# Autodesk Inventor assembly: PIHTI-for-Boron
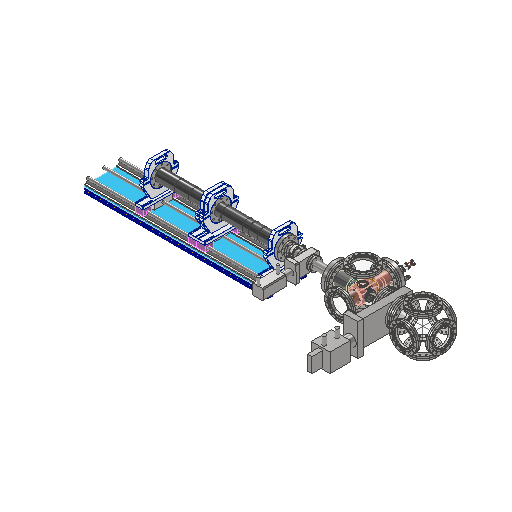
[picture p0: Inventor's stored thumbnail of the model, 512x512]
Saved by Autodesk Inventor 2027.1 (Build 311270010, 270A)
## iProperties
Created: 2024-05-09
Part Number: PIHTI-for-Boron
Document SubType Name: Assembly
Designer: kuzmin
Mass: 19614.5 g
Surface Area: 13609.5 cm^2
Volume: 3689.47 cm^3
Density: 5.31636 g/cm^3
Author: kuzmin
## Documents named in this file (21)
- D:\repos\PIHTI\bellows-probe_mizuno\PIHT-Bellows-probe.iam
- D:\repos\PIHTI\Plasma Vessel\Plasma-vacuum-cross\Plasma-vacuum-vessel-152IC-cross.iam
- D:\repos\PIHTI\Plasma Vessel\Plasma-Flange-2024\cathode-box-on-a-flange.iam
- D:\repos\PIHTI\Plasma Vessel\Cathode-Flange-Cage\CathodeCage.iam
- D:\repos\PIHTI\Plasma Vessel\Cathode-Anode-Flange\Cathode-Anode-70IC-flange-with-feeds.iam
- D:\repos\PIHTI\Plasma Vessel\Plasma-Box\Plasma-box-hayashi-aka-upgrade.iam
- D:\repos\PIHTI\ContentCenter\Fastners\M3x8-SHCS.ipt
- D:\repos\PIHTI\Plasma Vessel\Plasma-Box\probe-gate-with-spindel.iam
- D:\repos\PIHTI\Plasma Vessel\Cathode-Anode-Flange\cf70_spacer.ipt
- D:\repos\PIHTI\Plasma Vessel\Plasma-Box\anode-on-flange.iam
- D:\repos\PIHTI\Plasma Vessel\entrance-mesh-assembly.iam
- D:\repos\PIHTI\Plasma Vessel\probe-port-mesh-welded.iam
- D:\repos\PIHTI\Plasma Vessel\Cathode-Flange-Cage\Short-Cage.iam
- D:\repos\PIHTI\ContentCenter\CF-parts\CF-Flanges\CF_152-70.ipt
- D:\repos\PIHTI\ContentCenter\CF-parts\CF70-nipple\CF70-nipple.iam
- D:\repos\PIHTI\ContentCenter\CF-parts\CF70-gate-valve\Gatevalve_70_pneumatic.iam
- D:\repos\PIHTI\bellows-probe_mizuno\sliding-assembly.iam
- D:\repos\PIHTI\ContentCenter\CF-KF-adapters\ICF70_to_KF40.ipt
- D:\repos\PIHTI\ContentCenter\NW\NW40_clamp.ipt
- D:\repos\PIHTI\Plasma Vessel_2026\Plasma-vacuum-vessel\Plasma-vacuum-vessel-152IC-cross-L205p8.iam
- D:\repos\PIHTI\Plasma Vessel_2026\gate_valve\gate_valve_assembly.iam
## Components (27 placed, 20 different names)
1. Plasma-vacuum-vessel-152IC-cross:1 [sub-assembly] — メイト:1, フラッシュ:1, フラッシュ:2, 回転:1, リジッド:17, リジッド:18, メイト:22, メイト:23, メイト:24
2. cathode-box-on-a-flange:1 [sub-assembly] — 回転:1, 回転:2, メイト:2, メイト:5, リジッド:10
3. CathodeCage:1 [sub-assembly] — 回転:2
4. Cathode-Anode-70IC-flange-with-feeds:1 [sub-assembly] — メイト:2, メイト:5, メイト:6
5. Plasma-box-hayashi-aka-upgrade:1 [sub-assembly] — メイト:3, メイト:4, Hinge Angle, メイト:7, メイト:8, メイト:9, メイト:13, メイト:17
6. probe-gate-with-spindel:1 [sub-assembly] — メイト:3, メイト:4, Hinge Angle
7. cf70_spacer:1 — リジッド:10, メイト:6
8. anode-on-flange:1 [sub-assembly] — メイト:7, メイト:8, メイト:9, リジッド:11, リジッド:12, リジッド:13, リジッド:14
9. entrance-mesh-assembly:1 [sub-assembly] — メイト:13, メイト:17, メイト:19
10. probe-port-mesh-welded:1 [sub-assembly] — メイト:19
11. Short-Cage:1 [sub-assembly] — リジッド:17
12. CF_152-70:1 — リジッド:18, リジッド:21
13. CF70-nipple:1 [sub-assembly] — リジッド:21, リジッド:22
14. Gatevalve_70_pneumatic:1 [sub-assembly] — リジッド:22, 回転:3
15. ICF70_to_KF40:1 — 回転:3, メイト:20, メイト:21
16. sliding-assembly:1 [sub-assembly] — メイト:20, メイト:21, リジッド:23, 角度:2
17. NW40_clamp:1 — リジッド:23
18. gate_valve_assembly:1 [sub-assembly] — メイト:22, メイト:23, メイト:24, リジッド:24
19. Plasma-vacuum-vessel-152IC-cross-L205p8:1 [sub-assembly] — リジッド:24
20. SS ISO 4762 M3 x 8:5 — リジッド:11
21. SS ISO 4762 M3 x 8:6 — リジッド:12
22. SS ISO 4762 M3 x 8:7 — リジッド:14
23. SS ISO 4762 M3 x 8:8 — リジッド:13
24. SS ISO 4762 M3 x 8:1
25. SS ISO 4762 M3 x 8:2
26. SS ISO 4762 M3 x 8:3
27. SS ISO 4762 M3 x 8:4
## Relationships (35: Mate 17, WeldJoint 11, RevoluteJoint 3, Flush 2, Angle 2)
- メイト:1 [Mate]: Plasma-vacuum-vessel-152IC-cross:1
- フラッシュ:1 [Flush]: Plasma-vacuum-vessel-152IC-cross:1
- フラッシュ:2 [Flush]: Plasma-vacuum-vessel-152IC-cross:1
- 回転:1 [RevoluteJoint]: Plasma-vacuum-vessel-152IC-cross:1 ↔ cathode-box-on-a-flange:1
- 回転:2 [RevoluteJoint]: cathode-box-on-a-flange:1 ↔ CathodeCage:1
- メイト:2 [Mate]: cathode-box-on-a-flange:1 ↔ Cathode-Anode-70IC-flange-with-feeds:1
- メイト:3 [Mate]: Plasma-box-hayashi-aka-upgrade:1 ↔ probe-gate-with-spindel:1
- メイト:4 [Mate]: Plasma-box-hayashi-aka-upgrade:1 ↔ probe-gate-with-spindel:1
- Hinge Angle [Angle] (45 deg): Plasma-box-hayashi-aka-upgrade:1 ↔ probe-gate-with-spindel:1
- メイト:5 [Mate]: cathode-box-on-a-flange:1 ↔ Cathode-Anode-70IC-flange-with-feeds:1
- リジッド:10 [WeldJoint]: cathode-box-on-a-flange:1 ↔ cf70_spacer:1
- メイト:6 [Mate]: Cathode-Anode-70IC-flange-with-feeds:1 ↔ cf70_spacer:1
- メイト:7 [Mate]: Plasma-box-hayashi-aka-upgrade:1 ↔ anode-on-flange:1
- メイト:8 [Mate]: Plasma-box-hayashi-aka-upgrade:1 ↔ anode-on-flange:1
- メイト:9 [Mate]: Plasma-box-hayashi-aka-upgrade:1 ↔ anode-on-flange:1
- リジッド:11 [WeldJoint]: anode-on-flange:1 ↔ SS ISO 4762 M3 x 8:5
- リジッド:12 [WeldJoint]: anode-on-flange:1 ↔ SS ISO 4762 M3 x 8:6
- リジッド:13 [WeldJoint]: anode-on-flange:1 ↔ SS ISO 4762 M3 x 8:8
- リジッド:14 [WeldJoint]: anode-on-flange:1 ↔ SS ISO 4762 M3 x 8:7
- メイト:13 [Mate]: Plasma-box-hayashi-aka-upgrade:1 ↔ entrance-mesh-assembly:1
- メイト:17 [Mate]: Plasma-box-hayashi-aka-upgrade:1 ↔ entrance-mesh-assembly:1
- リジッド:17 [WeldJoint]: Plasma-vacuum-vessel-152IC-cross:1 ↔ Short-Cage:1
- メイト:19 [Mate]: entrance-mesh-assembly:1 ↔ probe-port-mesh-welded:1
- リジッド:18 [WeldJoint]: Plasma-vacuum-vessel-152IC-cross:1 ↔ CF_152-70:1
- リジッド:21 [WeldJoint]: CF_152-70:1 ↔ CF70-nipple:1
- リジッド:22 [WeldJoint]: CF70-nipple:1 ↔ Gatevalve_70_pneumatic:1
- 回転:3 [RevoluteJoint]: Gatevalve_70_pneumatic:1 ↔ ICF70_to_KF40:1
- メイト:20 [Mate]: ICF70_to_KF40:1 ↔ sliding-assembly:1
- メイト:21 [Mate]: ICF70_to_KF40:1 ↔ sliding-assembly:1
- リジッド:23 [WeldJoint] (-6.35 mm): sliding-assembly:1 ↔ NW40_clamp:1
- 角度:2 [Angle] (180 deg): sliding-assembly:1
- メイト:22 [Mate]: Plasma-vacuum-vessel-152IC-cross:1 ↔ gate_valve_assembly:1
- メイト:23 [Mate]: Plasma-vacuum-vessel-152IC-cross:1 ↔ gate_valve_assembly:1
- メイト:24 [Mate]: Plasma-vacuum-vessel-152IC-cross:1 ↔ gate_valve_assembly:1
- リジッド:24 [WeldJoint]: gate_valve_assembly:1 ↔ Plasma-vacuum-vessel-152IC-cross-L205p8:1
